# Autodesk Inventor assembly: cácon cá 3d thứ 2
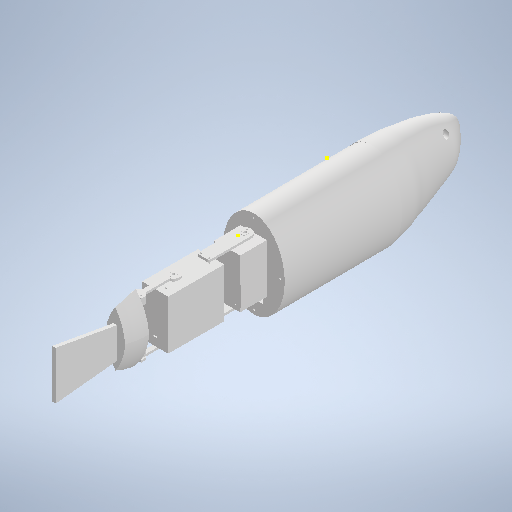
[picture p0: Inventor's stored thumbnail of the model, 512x512]
Saved by Autodesk Inventor 2025.1 (Build 291241020, 241B)
## iProperties
Created: 2025-07-18
Part Number: cácon cá 3d thứ 2
Document SubType Name: Assembly
Designer: Laptop
Sending System: Autodesk Inventor 2025
Preprocessor: ST-DEVELOPER v20
Author: thita
## Documents named in this file (13)
- D:\Year2\đồ án tốt nghịp\cácon cá 3d thứ 2.iam
- D:\Year2\đồ án tốt nghịp\3d\cánap duoi servo (1) (2).ipt
- D:\Year2\đồ án tốt nghịp\3d\cáhộp servo (2) (1).ipt
- D:\Year2\đồ án tốt nghịp\3d\cátrục (1).ipt
- D:\Year2\đồ án tốt nghịp\3d\cáthanh tam giác 2.ipt
- D:\Year2\đồ án tốt nghịp\3d\cáThanh tam giác 1.ipt
- D:\Year2\đồ án tốt nghịp\3d\cáthanh liên kết đuôi 2.ipt
- D:\Year2\đồ án tốt nghịp\3d\cáthanh liên kết đuôi 1.ipt
- D:\Year2\đồ án tốt nghịp\3d\cáthanh kẹp đuôi (1).ipt
- D:\Year2\đồ án tốt nghịp\3d\cánắp đầu cá (1) (1)_MIR.ipt
- D:\Year2\đồ án tốt nghịp\3d\cánap tren servo_MIR_MIR.ipt
- D:\Year2\đồ án tốt nghịp\3d\cáđầu ca 2_MIR.ipt
- D:\Year2\đồ án tốt nghịp\3d\cáđuôi cá.ipt
## Components (14 placed, 12 different names)
1. nap duoi servo (1) (2):1
2. hộp servo (2) (1):1
3. trục (1):1 — Mate:1
4. thanh tam giác 2:1
5. Thanh tam giác 1:1
6. thanh liên kết đuôi 2:1
7. thanh liên kết đuôi 1:1
8. thanh kẹp đuôi (1):1
9. nắp đầu cá (1) (1)_MIR:1 — Mate:1, Mate:2
10. nap duoi servo (1) (2):2
11. nap tren servo_MIR_MIR:1
12. trục (1):2
13. đầu ca 2_MIR:1 — Mate:2
14. đuôi cá:1
## Relationships (2: Mate 2)
- Mate:1: trục (1):1 ↔ nắp đầu cá (1) (1)_MIR:1
- Mate:2: nắp đầu cá (1) (1)_MIR:1 ↔ đầu ca 2_MIR:1
